# Autodesk Inventor assembly: Ensamblaje_Exoesqueleto
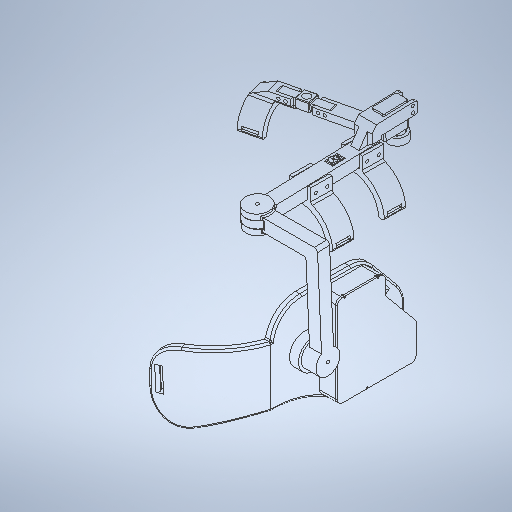
[picture p0: Inventor's stored thumbnail of the model, 512x512]
Saved by Autodesk Inventor 2026 (Build 300175000, 175)
## iProperties
Created: 2025-07-01
Part Number: Ensamblaje_Exoesqueleto
Document SubType Name: Assembly
Designer: HP
Author: HP
## Documents named in this file (13)
- C:\Users\Hanns\Downloads\INTELIG.ARTIF. Y SISTEM. LOG\INTELIG.ARTIF. Y SISTEM. LOG\PROYECTO DIBUJO MECATRONICO\Examen T1\Ensamblaje_Exoesqueleto.iam
- C:\Users\Hanns\Downloads\INTELIG.ARTIF. Y SISTEM. LOG\INTELIG.ARTIF. Y SISTEM. LOG\PROYECTO DIBUJO MECATRONICO\Examen T1\CINTA 1_2.ipt
- C:\Users\Hanns\Downloads\INTELIG.ARTIF. Y SISTEM. LOG\INTELIG.ARTIF. Y SISTEM. LOG\PROYECTO DIBUJO MECATRONICO\Examen T1\CINTA 2_1.ipt
- C:\Users\Hanns\Downloads\INTELIG.ARTIF. Y SISTEM. LOG\INTELIG.ARTIF. Y SISTEM. LOG\PROYECTO DIBUJO MECATRONICO\Examen T1\SOPORTE SUPERIOR_1.ipt
- C:\Users\Hanns\Downloads\INTELIG.ARTIF. Y SISTEM. LOG\INTELIG.ARTIF. Y SISTEM. LOG\PROYECTO DIBUJO MECATRONICO\Examen T1\MOTOR.ipt
- C:\Users\Hanns\Downloads\INTELIG.ARTIF. Y SISTEM. LOG\INTELIG.ARTIF. Y SISTEM. LOG\PROYECTO DIBUJO MECATRONICO\Examen T1\SOPORTE INFERIOR_1.ipt
- C:\Users\Hanns\Downloads\INTELIG.ARTIF. Y SISTEM. LOG\INTELIG.ARTIF. Y SISTEM. LOG\PROYECTO DIBUJO MECATRONICO\Examen T1\BASE BUZZER.ipt
- C:\Users\Hanns\Downloads\INTELIG.ARTIF. Y SISTEM. LOG\INTELIG.ARTIF. Y SISTEM. LOG\PROYECTO DIBUJO MECATRONICO\Examen T1\CINTA 3_1.ipt
- C:\Users\Hanns\Downloads\INTELIG.ARTIF. Y SISTEM. LOG\INTELIG.ARTIF. Y SISTEM. LOG\PROYECTO DIBUJO MECATRONICO\Examen T1\CONECTOR ROTATIV0.ipt
- C:\Users\Hanns\Downloads\INTELIG.ARTIF. Y SISTEM. LOG\INTELIG.ARTIF. Y SISTEM. LOG\PROYECTO DIBUJO MECATRONICO\Examen T1\APOYO ESPALDAR_1.ipt
- C:\Users\Hanns\Downloads\INTELIG.ARTIF. Y SISTEM. LOG\INTELIG.ARTIF. Y SISTEM. LOG\PROYECTO DIBUJO MECATRONICO\Examen T1\CAJA.ipt
- C:\Users\Hanns\Downloads\INTELIG.ARTIF. Y SISTEM. LOG\INTELIG.ARTIF. Y SISTEM. LOG\PROYECTO DIBUJO MECATRONICO\Examen T1\TAPA_2.ipt
- C:\Users\Hanns\Downloads\INTELIG.ARTIF. Y SISTEM. LOG\INTELIG.ARTIF. Y SISTEM. LOG\PROYECTO DIBUJO MECATRONICO\Examen T1\SUICHE.ipt
## Components (12 placed, 12 different names)
1. CINTA 1_2:1 — Coincidencia:13, Coincidencia:14
2. CINTA 2_1:1 — Coincidencia:15, Coincidencia:16
3. SOPORTE SUPERIOR_1:1 — Coincidencia:3, Coincidencia:4, Coincidencia:5, Coincidencia:6, Coincidencia:13, Coincidencia:14, Coincidencia:15, Coincidencia:16, Coincidencia:24, Coincidencia:25
4. MOTOR:1 — Coincidencia:5, Coincidencia:6, Coincidencia:7, Coincidencia:8
5. SOPORTE INFERIOR_1:1 — Coincidencia:7, Coincidencia:8, Coincidencia:10, Coincidencia:26, Coincidencia:27
6. BASE BUZZER:1 — Coincidencia:10, Coincidencia:12, Coincidencia:26, Coincidencia:27, Coincidencia:28, Coincidencia:29, Coincidencia:30, Coincidencia:31
7. CINTA 3_1:1 — Coincidencia:12, Coincidencia:28, Coincidencia:29, Coincidencia:30, Coincidencia:31
8. CONECTOR ROTATIV0:1 — Coincidencia:1, Coincidencia:2, Coincidencia:3, Coincidencia:4
9. APOYO ESPALDAR_1:1 — Coincidencia:1, Coincidencia:2, Coincidencia:18, Coincidencia:19, Coincidencia:20
10. CAJA:1 — Coincidencia:18, Coincidencia:19, Coincidencia:20, Coincidencia:21, Coincidencia:22, Coincidencia:23
11. TAPA_2:1 — Coincidencia:21, Coincidencia:22, Coincidencia:23
12. SUICHE:1 — Coincidencia:24, Coincidencia:25
## Relationships (28: Mate 28)
- Coincidencia:1 [Mate]: CONECTOR ROTATIV0:1 ↔ APOYO ESPALDAR_1:1
- Coincidencia:2 [Mate]: CONECTOR ROTATIV0:1 ↔ APOYO ESPALDAR_1:1
- Coincidencia:3 [Mate]: SOPORTE SUPERIOR_1:1 ↔ CONECTOR ROTATIV0:1
- Coincidencia:4 [Mate] (0.5 mm): SOPORTE SUPERIOR_1:1 ↔ CONECTOR ROTATIV0:1
- Coincidencia:5 [Mate]: SOPORTE SUPERIOR_1:1 ↔ MOTOR:1
- Coincidencia:6 [Mate]: SOPORTE SUPERIOR_1:1 ↔ MOTOR:1
- Coincidencia:7 [Mate]: MOTOR:1 ↔ SOPORTE INFERIOR_1:1
- Coincidencia:8 [Mate]: MOTOR:1 ↔ SOPORTE INFERIOR_1:1
- Coincidencia:10 [Mate]: SOPORTE INFERIOR_1:1 ↔ BASE BUZZER:1
- Coincidencia:12 [Mate]: BASE BUZZER:1 ↔ CINTA 3_1:1
- Coincidencia:13 [Mate]: CINTA 1_2:1 ↔ SOPORTE SUPERIOR_1:1
- Coincidencia:14 [Mate] (1 mm): CINTA 1_2:1 ↔ SOPORTE SUPERIOR_1:1
- Coincidencia:15 [Mate]: CINTA 2_1:1 ↔ SOPORTE SUPERIOR_1:1
- Coincidencia:16 [Mate] (1 mm): CINTA 2_1:1 ↔ SOPORTE SUPERIOR_1:1
- Coincidencia:18 [Mate]: APOYO ESPALDAR_1:1 ↔ CAJA:1
- Coincidencia:19 [Mate]: APOYO ESPALDAR_1:1 ↔ CAJA:1
- Coincidencia:20 [Mate]: APOYO ESPALDAR_1:1 ↔ CAJA:1
- Coincidencia:21 [Mate]: CAJA:1 ↔ TAPA_2:1
- Coincidencia:22 [Mate]: CAJA:1 ↔ TAPA_2:1
- Coincidencia:23 [Mate]: CAJA:1 ↔ TAPA_2:1
- Coincidencia:24 [Mate]: SOPORTE SUPERIOR_1:1 ↔ SUICHE:1
- Coincidencia:25 [Mate]: SOPORTE SUPERIOR_1:1 ↔ SUICHE:1
- Coincidencia:26 [Mate]: SOPORTE INFERIOR_1:1 ↔ BASE BUZZER:1
- Coincidencia:27 [Mate]: SOPORTE INFERIOR_1:1 ↔ BASE BUZZER:1
- Coincidencia:28 [Mate]: BASE BUZZER:1 ↔ CINTA 3_1:1
- Coincidencia:29 [Mate]: BASE BUZZER:1 ↔ CINTA 3_1:1
- Coincidencia:30 [Mate]: BASE BUZZER:1 ↔ CINTA 3_1:1
- Coincidencia:31 [Mate]: BASE BUZZER:1 ↔ CINTA 3_1:1
## Named parameters: Finish1_Area = 2458.06, Finish2_Area = 2227.43, Finish2_Depth = 0.03 mm, Finish3_Area = 41.7598, Finish4_Area = 224.289
note: some values were not read from the file. Shown as the stored number, unit unknown: "Finish1_Area", "Finish2_Area", "Finish3_Area", "Finish4_Area".
